# Autodesk Inventor assembly: sheet2
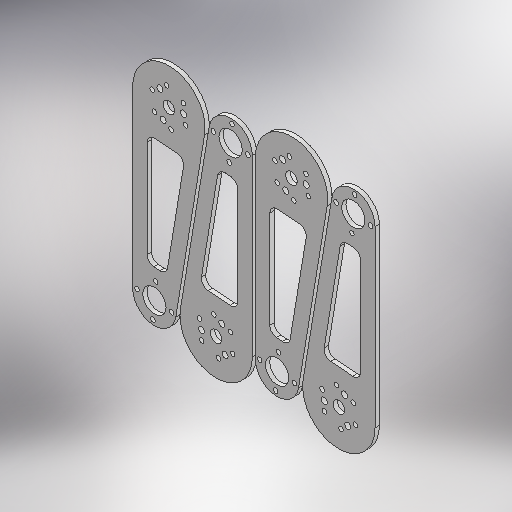
[picture p0: Inventor's stored thumbnail of the model, 512x512]
Saved by Autodesk Inventor 2025.3 (Build 293356030, 356C)
## iProperties
Created: 2026-06-14
Part Number: sheet2
Document SubType Name: Assembly
Designer: ibuki_ono
Author: ibuki_ono
## Documents named in this file (3)
- C:\Users\ibuki_ono\Documents\hobby\rogiken\catchrobo\2026_CAD\Hardware_2026\Inventor\base_table\nesting\sheet2.iam
- C:\Users\ibuki_ono\Documents\ストック一般_シート.2 (1).ipt
- C:\Users\ibuki_ono\Documents\CP4.0_base-arm1.ipt
## Components (5 placed, 2 different names)
1. ストック一般:1
2. CP4.0_base-arm1:1 — フラッシュ:2, メイト:3, メイト:7
3. CP4.0_base-arm1:2 — フラッシュ:3, メイト:2, メイト:3, メイト:6
4. CP4.0_base-arm1:3 — フラッシュ:1, メイト:1, メイト:2, メイト:5
5. CP4.0_base-arm1:4 — フラッシュ:1, フラッシュ:2, フラッシュ:3, メイト:1, メイト:4, フラッシュ:4
## Relationships (11: Mate 7, Flush 4)
- フラッシュ:1 [Flush]: CP4.0_base-arm1:3 ↔ CP4.0_base-arm1:4
- フラッシュ:2 [Flush]: CP4.0_base-arm1:1 ↔ CP4.0_base-arm1:4
- フラッシュ:3 [Flush]: CP4.0_base-arm1:2 ↔ CP4.0_base-arm1:4
- メイト:1 [Mate] (2.1 mm): CP4.0_base-arm1:3 ↔ CP4.0_base-arm1:4
- メイト:2 [Mate] (2.1 mm): CP4.0_base-arm1:2 ↔ CP4.0_base-arm1:3
- メイト:3 [Mate] (2.1 mm): CP4.0_base-arm1:1 ↔ CP4.0_base-arm1:2
- メイト:4 [Mate]: CP4.0_base-arm1:4
- メイト:5 [Mate]: CP4.0_base-arm1:3
- メイト:6 [Mate]: CP4.0_base-arm1:2
- メイト:7 [Mate]: CP4.0_base-arm1:1
- フラッシュ:4 [Flush]: CP4.0_base-arm1:4
